# Autodesk Inventor assembly: EG_Boite
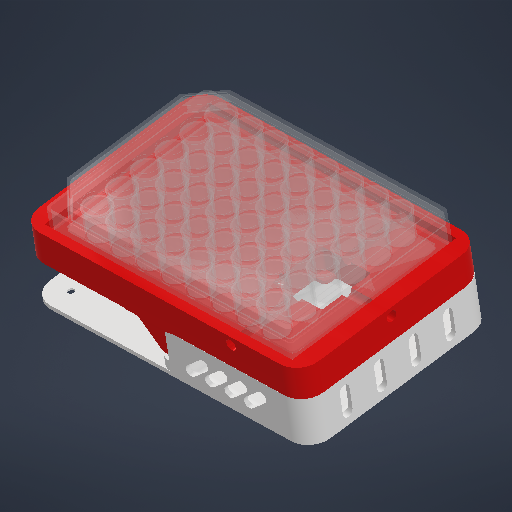
[picture p0: Inventor's stored thumbnail of the model, 512x512]
Saved by Autodesk Inventor 2026.1 (Build 301233020, 233B)
## iProperties
Created: 2026-06-04
Part Number: EG_Boite
Document SubType Name: Assembly
Designer: matpo
Author: matpo
## Documents named in this file (7)
- C:\Users\matpo\OneDrive - HESSO\2Annee\Projet_Thématique_PB0326\2_Partie_Mecanique\EG_Boite.iam
- C:\Users\matpo\OneDrive - HESSO\2Annee\Projet_Thématique_PB0326\2_Partie_Mecanique\plaque1intboite.ipt
- C:\Users\matpo\OneDrive - HESSO\2Annee\Projet_Thématique_PB0326\2_Partie_Mecanique\plaque2intboite.ipt
- C:\Users\matpo\OneDrive - HESSO\2Annee\Projet_Thématique_PB0326\2_Partie_Mecanique\sensirion-scd40-scd41-1.snapshot.26\scd40 v7\scd40 v7\scd40 v7.ipt
- C:\Users\matpo\OneDrive - HESSO\2Annee\Projet_Thématique_PB0326\2_Partie_Mecanique\sensirion-scd40-scd41-1.snapshot.26\scd40 v7\boitedepetrie.ipt
- C:\Users\matpo\OneDrive - HESSO\2Annee\Projet_Thématique_PB0326\2_Partie_Mecanique\supportscd40.ipt
- C:\Users\matpo\OneDrive - HESSO\2Annee\Projet_Thématique_PB0326\2_Partie_Mecanique\impression\joint.ipt
## Components (6 placed, 6 different names)
1. plaque1intboite:1 — Affleurement:1, Affleurement:2
2. plaque2intboite:1 — Affleurement:1, Affleurement:2, Placage:1, Placage:2, Placage:3, Affleurement:7, Placage:4, Placage:5, Placage:6, Affleurement:8
3. scd40 v7:1 — Placage:1, Placage:2, Placage:3
4. boitedepetrie:1 — Placage:4, Placage:5, Placage:6
5. supportscd40:1 — Affleurement:7
6. joint:1 — Affleurement:8
## Relationships (10: Mate 6, Flush 4)
- Affleurement:1 [Flush]: plaque1intboite:1 ↔ plaque2intboite:1
- Affleurement:2 [Flush]: plaque1intboite:1 ↔ plaque2intboite:1
- Placage:1 [Mate]: plaque2intboite:1 ↔ scd40 v7:1
- Placage:2 [Mate]: plaque2intboite:1 ↔ scd40 v7:1
- Placage:3 [Mate]: plaque2intboite:1 ↔ scd40 v7:1
- Affleurement:7 [Flush]: plaque2intboite:1 ↔ supportscd40:1
- Placage:4 [Mate]: plaque2intboite:1 ↔ boitedepetrie:1
- Placage:5 [Mate]: plaque2intboite:1 ↔ boitedepetrie:1
- Placage:6 [Mate]: plaque2intboite:1 ↔ boitedepetrie:1
- Affleurement:8 [Flush]: plaque2intboite:1 ↔ joint:1
